# Autodesk Inventor assembly: QArm Gripper
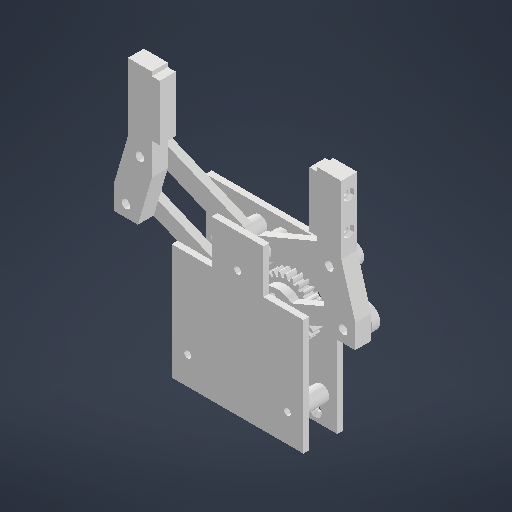
[picture p0: Inventor's stored thumbnail of the model, 512x512]
Saved by Autodesk Inventor 2027.1 (Build 311270010, 270A)
## iProperties
Created: 2026-10-26
Part Number: QArm Gripper
Document SubType Name: Assembly
Designer: anshi
Author: anshi
## Documents named in this file (17)
- C:\Users\anshi\Desktop\school\1P13\Design Studio\proj1 cad1\QArm Gripper.iam
- C:\Users\anshi\Desktop\school\1P13\Design Studio\proj1 cad1\P1-01_Lower_Mounting_Frame.ipt
- C:\Users\anshi\Desktop\school\1P13\Design Studio\proj1 cad1\P4-04 Upper axle-support plate.ipt
- C:\Users\anshi\Desktop\school\1P13\Design Studio\proj1 cad1\P1-02 Design Study Structural Pillar.ipt
- P1-02 Design Studio Structural Pillar.ipt
- C:\Users\anshi\Desktop\school\1P13\Design Studio\proj1 cad1\P2-01 Input pinion 18 teeth.ipt
- C:\Users\anshi\Desktop\school\1P13\Design Studio\proj1 cad1\P2-02 Left driven gear 26 teeth.ipt
- C:\Users\anshi\Desktop\school\1P13\Design Studio\proj1 cad1\UpperCrankline.ipt
- C:\Users\anshi\Desktop\school\1P13\Design Studio\proj1 cad1\LowerFollowerLink.ipt
- C:\Users\anshi\Desktop\school\1P13\Design Studio\proj1 cad1\LowerPivotSpacer.ipt
- C:\Users\anshi\Desktop\school\1P13\Design Studio\proj1 cad1\P4-01 Left finger.ipt
- C:\Users\anshi\Desktop\school\1P13\Design Studio\proj1 cad1\P4-03 Pad carrier.ipt
- C:\Users\anshi\Desktop\school\1P13\Design Studio\proj1 cad1\P4-05 Foam contact pad.ipt
- C:\Users\anshi\Desktop\school\1P13\Design Studio\proj1 cad1\P2-03 Right driven gear 26 teeth.ipt
- C:\Users\anshi\Desktop\school\1P13\Design Studio\proj1 cad1\P4-02 Right finger.ipt
- C:\Users\anshi\Desktop\school\1P13\Design Studio\proj1 cad1\UpperPivotSpacer.ipt
- C:\Users\anshi\Desktop\school\1P13\Design Studio\proj1 cad1\MetalAxle.ipt
## Components (28 placed, 28 different names)
1. Lower mounting frame — Upper plate - datum 1, Upper plate - datum 2, Upper plate - datum 3, Structural pillar 1 - datum 1, Structural pillar 1 - datum 2, Structural pillar 1 - datum 3, Structural pillar 2 - datum 1, Structural pillar 2 - datum 2, Structural pillar 2 - datum 3, Structural pillar 3 - datum 1, Structural pillar 3 - datum 2, Structural pillar 3 - datum 3, Left lower pivot spacer - datum 1, Left lower pivot spacer - datum 2, Left lower pivot spacer - datum 3, Right lower pivot spacer - datum 1, Right lower pivot spacer - datum 2, Right lower pivot spacer - datum 3, Upper pivot spacer 1 - datum 1, Upper pivot spacer 1 - datum 2, Upper pivot spacer 1 - datum 3, Metal axle 1 - datum 1, Metal axle 1 - datum 2, Metal axle 1 - datum 3, Upper pivot spacer 2 - datum 1, Upper pivot spacer 2 - datum 2, Upper pivot spacer 2 - datum 3, Metal axle 2 - datum 1, Metal axle 2 - datum 2, Metal axle 2 - datum 3, Upper pivot spacer 3 - datum 1, Upper pivot spacer 3 - datum 2, Upper pivot spacer 3 - datum 3, Metal axle 3 - datum 1, Metal axle 3 - datum 2, Metal axle 3 - datum 3, Upper pivot spacer 4 - datum 1, Upper pivot spacer 4 - datum 2, Upper pivot spacer 4 - datum 3, Metal axle 4 - datum 1, Metal axle 4 - datum 2, Metal axle 4 - datum 3, Input pinion height, Input shaft axis, Left gear face height, Left gear pivot, Left follower height, Left follower base pivot, Left finger height, Right gear face height, Right gear pivot, Right follower height, Right follower base pivot, Right finger height, Jaw opening drive
2. Upper axle-support plate — Upper plate - datum 1, Upper plate - datum 2, Upper plate - datum 3
3. Structural pillar 1 — Structural pillar 1 - datum 1, Structural pillar 1 - datum 2, Structural pillar 1 - datum 3
4. Structural pillar 2 — Structural pillar 2 - datum 1, Structural pillar 2 - datum 2, Structural pillar 2 - datum 3
5. Structural pillar 3 — Structural pillar 3 - datum 1, Structural pillar 3 - datum 2, Structural pillar 3 - datum 3
6. Motor input pinion 18T — Input pinion height, Input shaft axis, 26T to 18T external gear mesh
7. Left driven gear 26T — Left gear face height, Left gear pivot, Left crank gear clearance, Left crank root, Left crank bolt indexing, 26T to 26T external gear mesh, 26T to 18T external gear mesh, Jaw opening drive
8. Left upper crank — Left crank gear clearance, Left crank root, Left crank bolt indexing, Left finger upper pivot
9. Left lower follower — Left follower height, Left follower base pivot, Left finger lower pivot
10. Left lower pivot spacer — Left lower pivot spacer - datum 1, Left lower pivot spacer - datum 2, Left lower pivot spacer - datum 3
11. Left finger — Left finger height, Left finger upper pivot, Left finger lower pivot, Left pad carrier - datum 1, Left pad carrier - datum 2, Left pad carrier - datum 3
12. Left pad carrier — Left pad carrier - datum 1, Left pad carrier - datum 2, Left pad carrier - datum 3, Left foam pad - datum 1, Left foam pad - datum 2, Left foam pad - datum 3
13. Left foam contact pad — Left foam pad - datum 1, Left foam pad - datum 2, Left foam pad - datum 3
14. Right driven gear 26T — Right gear face height, Right gear pivot, Right crank gear clearance, Right crank root, Right crank bolt indexing, 26T to 26T external gear mesh
15. Right upper crank — Right crank gear clearance, Right crank root, Right crank bolt indexing, Right finger upper pivot
16. Right lower follower — Right follower height, Right follower base pivot, Right finger lower pivot
17. Right lower pivot spacer — Right lower pivot spacer - datum 1, Right lower pivot spacer - datum 2, Right lower pivot spacer - datum 3
18. Right finger — Right finger height, Right finger upper pivot, Right finger lower pivot, Right pad carrier - datum 1, Right pad carrier - datum 2, Right pad carrier - datum 3
19. Right pad carrier — Right pad carrier - datum 1, Right pad carrier - datum 2, Right pad carrier - datum 3, Right foam pad - datum 1, Right foam pad - datum 2, Right foam pad - datum 3
20. Right foam contact pad — Right foam pad - datum 1, Right foam pad - datum 2, Right foam pad - datum 3
21. Upper pivot spacer 1 — Upper pivot spacer 1 - datum 1, Upper pivot spacer 1 - datum 2, Upper pivot spacer 1 - datum 3
22. Metal axle 1 — Metal axle 1 - datum 1, Metal axle 1 - datum 2, Metal axle 1 - datum 3
23. Upper pivot spacer 2 — Upper pivot spacer 2 - datum 1, Upper pivot spacer 2 - datum 2, Upper pivot spacer 2 - datum 3
24. Metal axle 2 — Metal axle 2 - datum 1, Metal axle 2 - datum 2, Metal axle 2 - datum 3
25. Upper pivot spacer 3 — Upper pivot spacer 3 - datum 1, Upper pivot spacer 3 - datum 2, Upper pivot spacer 3 - datum 3
26. Metal axle 3 — Metal axle 3 - datum 1, Metal axle 3 - datum 2, Metal axle 3 - datum 3
27. Upper pivot spacer 4 — Upper pivot spacer 4 - datum 1, Upper pivot spacer 4 - datum 2, Upper pivot spacer 4 - datum 3
28. Metal axle 4 — Metal axle 4 - datum 1, Metal axle 4 - datum 2, Metal axle 4 - datum 3
## Relationships (79: Flush 46, Mate 30, RelateRotation 2, Angle 1)
- Upper plate - datum 1 [Flush]: Lower mounting frame ↔ Upper axle-support plate
- Upper plate - datum 2 [Flush]: Lower mounting frame ↔ Upper axle-support plate
- Upper plate - datum 3 [Flush] (17 mm): Lower mounting frame ↔ Upper axle-support plate
- Structural pillar 1 - datum 1 [Flush] (-12 mm): Lower mounting frame ↔ Structural pillar 1
- Structural pillar 1 - datum 2 [Flush] (3 mm): Lower mounting frame ↔ Structural pillar 1
- Structural pillar 1 - datum 3 [Mate] (-12 mm): Lower mounting frame ↔ Structural pillar 1
- Structural pillar 2 - datum 1 [Flush] (38 mm): Lower mounting frame ↔ Structural pillar 2
- Structural pillar 2 - datum 2 [Flush] (3 mm): Lower mounting frame ↔ Structural pillar 2
- Structural pillar 2 - datum 3 [Mate] (-12 mm): Lower mounting frame ↔ Structural pillar 2
- Structural pillar 3 - datum 1 [Flush] (13 mm): Lower mounting frame ↔ Structural pillar 3
- Structural pillar 3 - datum 2 [Flush] (3 mm): Lower mounting frame ↔ Structural pillar 3
- Structural pillar 3 - datum 3 [Mate] (37 mm): Lower mounting frame ↔ Structural pillar 3
- Left lower pivot spacer - datum 1 [Flush] (7 mm): Lower mounting frame ↔ Left lower pivot spacer
- Left lower pivot spacer - datum 2 [Flush] (3 mm): Lower mounting frame ↔ Left lower pivot spacer
- Left lower pivot spacer - datum 3 [Mate] (46 mm): Lower mounting frame ↔ Left lower pivot spacer
- Right lower pivot spacer - datum 1 [Flush] (19 mm): Lower mounting frame ↔ Right lower pivot spacer
- Right lower pivot spacer - datum 2 [Flush] (3 mm): Lower mounting frame ↔ Right lower pivot spacer
- Right lower pivot spacer - datum 3 [Mate] (46 mm): Lower mounting frame ↔ Right lower pivot spacer
- Upper pivot spacer 1 - datum 1 [Flush]: Lower mounting frame ↔ Upper pivot spacer 1
- Upper pivot spacer 1 - datum 2 [Flush] (13 mm): Lower mounting frame ↔ Upper pivot spacer 1
- Upper pivot spacer 1 - datum 3 [Mate] (22 mm): Lower mounting frame ↔ Upper pivot spacer 1
- Metal axle 1 - datum 1 [Flush]: Lower mounting frame ↔ Metal axle 1
- Metal axle 1 - datum 2 [Flush] (1 mm): Lower mounting frame ↔ Metal axle 1
- Metal axle 1 - datum 3 [Mate] (22 mm): Lower mounting frame ↔ Metal axle 1
- Upper pivot spacer 2 - datum 1 [Flush] (26 mm): Lower mounting frame ↔ Upper pivot spacer 2
- Upper pivot spacer 2 - datum 2 [Flush] (13 mm): Lower mounting frame ↔ Upper pivot spacer 2
- Upper pivot spacer 2 - datum 3 [Mate] (22 mm): Lower mounting frame ↔ Upper pivot spacer 2
- Metal axle 2 - datum 1 [Flush] (26 mm): Lower mounting frame ↔ Metal axle 2
- Metal axle 2 - datum 2 [Flush] (1 mm): Lower mounting frame ↔ Metal axle 2
- Metal axle 2 - datum 3 [Mate] (22 mm): Lower mounting frame ↔ Metal axle 2
- Upper pivot spacer 3 - datum 1 [Flush] (7 mm): Lower mounting frame ↔ Upper pivot spacer 3
- Upper pivot spacer 3 - datum 2 [Flush] (13 mm): Lower mounting frame ↔ Upper pivot spacer 3
- Upper pivot spacer 3 - datum 3 [Mate] (46 mm): Lower mounting frame ↔ Upper pivot spacer 3
- Metal axle 3 - datum 1 [Flush] (7 mm): Lower mounting frame ↔ Metal axle 3
- Metal axle 3 - datum 2 [Flush] (1 mm): Lower mounting frame ↔ Metal axle 3
- Metal axle 3 - datum 3 [Mate] (46 mm): Lower mounting frame ↔ Metal axle 3
- Upper pivot spacer 4 - datum 1 [Flush] (19 mm): Lower mounting frame ↔ Upper pivot spacer 4
- Upper pivot spacer 4 - datum 2 [Flush] (13 mm): Lower mounting frame ↔ Upper pivot spacer 4
- Upper pivot spacer 4 - datum 3 [Mate] (46 mm): Lower mounting frame ↔ Upper pivot spacer 4
- Metal axle 4 - datum 1 [Flush] (19 mm): Lower mounting frame ↔ Metal axle 4
- Metal axle 4 - datum 2 [Flush] (1 mm): Lower mounting frame ↔ Metal axle 4
- Metal axle 4 - datum 3 [Mate] (46 mm): Lower mounting frame ↔ Metal axle 4
- Input pinion height [Flush] (0.5 mm): Lower mounting frame ↔ Motor input pinion 18T
- Input shaft axis [Mate]: Lower mounting frame ↔ Motor input pinion 18T
- Left gear face height [Flush] (3.5 mm): Lower mounting frame ↔ Left driven gear 26T
- Left gear pivot [Mate]: Lower mounting frame ↔ Left driven gear 26T
- Left crank gear clearance [Mate] (5.5 mm): Left driven gear 26T ↔ Left upper crank
- Left crank root [Mate]: Left driven gear 26T ↔ Left upper crank
- Left crank bolt indexing [Mate]: Left driven gear 26T ↔ Left upper crank
- Left follower height [Flush] (9 mm): Lower mounting frame ↔ Left lower follower
- Left follower base pivot [Mate]: Lower mounting frame ↔ Left lower follower
- Left finger height [Flush] (13.5 mm): Lower mounting frame ↔ Left finger
- Left finger upper pivot [Mate]: Left upper crank ↔ Left finger
- Left finger lower pivot [Mate]: Left lower follower ↔ Left finger
- Left pad carrier - datum 1 [Flush] (34 mm): Left finger ↔ Left pad carrier
- Left pad carrier - datum 2 [Flush]: Left finger ↔ Left pad carrier
- Left pad carrier - datum 3 [Flush] (13 mm): Left finger ↔ Left pad carrier
- Left foam pad - datum 1 [Flush]: Left pad carrier ↔ Left foam contact pad
- Left foam pad - datum 2 [Flush]: Left pad carrier ↔ Left foam contact pad
- Left foam pad - datum 3 [Flush] (2 mm): Left pad carrier ↔ Left foam contact pad
- Right gear face height [Flush] (3.5 mm): Lower mounting frame ↔ Right driven gear 26T
- Right gear pivot [Mate]: Lower mounting frame ↔ Right driven gear 26T
- Right crank gear clearance [Mate] (5.5 mm): Right driven gear 26T ↔ Right upper crank
- Right crank root [Mate]: Right driven gear 26T ↔ Right upper crank
- Right crank bolt indexing [Mate]: Right driven gear 26T ↔ Right upper crank
- Right follower height [Flush] (9 mm): Lower mounting frame ↔ Right lower follower
- Right follower base pivot [Mate]: Lower mounting frame ↔ Right lower follower
- Right finger height [Flush] (13.5 mm): Lower mounting frame ↔ Right finger
- Right finger upper pivot [Mate]: Right upper crank ↔ Right finger
- Right finger lower pivot [Mate]: Right lower follower ↔ Right finger
- Right pad carrier - datum 1 [Flush] (34 mm): Right finger ↔ Right pad carrier
- Right pad carrier - datum 2 [Mate] (8 mm): Right finger ↔ Right pad carrier
- Right pad carrier - datum 3 [Mate] (-13 mm): Right finger ↔ Right pad carrier
- Right foam pad - datum 1 [Flush]: Right pad carrier ↔ Right foam contact pad
- Right foam pad - datum 2 [Flush]: Right pad carrier ↔ Right foam contact pad
- Right foam pad - datum 3 [Flush] (2 mm): Right pad carrier ↔ Right foam contact pad
- 26T to 26T external gear mesh [RelateRotation] (1 ul): Left driven gear 26T ↔ Right driven gear 26T
- 26T to 18T external gear mesh [RelateRotation] (1.4444 ul): Motor input pinion 18T ↔ Left driven gear 26T
- Jaw opening drive [Angle] (67.2531 deg): Lower mounting frame ↔ Left driven gear 26T
## Named parameters: JawOpening = 75 mm, LinkLength = 45 mm, ObjectWidth = 70 mm
